# Autodesk Inventor assembly: 电机传动
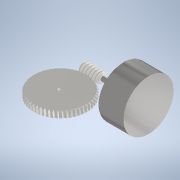
[picture p0: Inventor's stored thumbnail of the model, 180x180]
Saved by Autodesk Inventor 2021 (Build 250183000, 183)
## iProperties
Created: 2024-05-08
Part Number: 电机传动
Document SubType Name: Assembly
Designer: admin
Author: admin
## Documents named in this file (4)
- G:\月球车模型-耿晨译\电机传动.iam
- G:\月球车模型-耿晨译\蜗杆.ipt
- G:\月球车模型-耿晨译\300电机.ipt
- G:\月球车模型-耿晨译\蜗轮.ipt
## Components (3 placed, 3 different names)
1. 300电机:1 — 刚性:1, 配合:1
2. 蜗杆:1 — 刚性:1, 配合:1, 配合:2
3. 蜗轮:1 — 配合:2
## Relationships (3: Mate 2, WeldJoint 1)
- 刚性:1 [WeldJoint]: 300电机:1 ↔ 蜗杆:1
- 配合:1 [Mate]: 300电机:1 ↔ 蜗杆:1
- 配合:2 [Mate]: 蜗杆:1 ↔ 蜗轮:1
